# Autodesk Inventor assembly: 2ND STEP GEARX
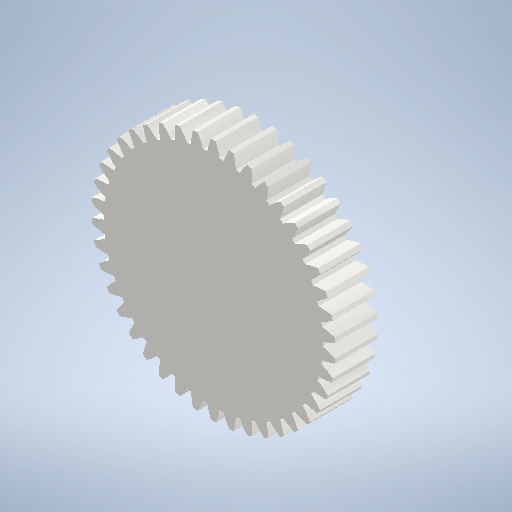
[picture p0: Inventor's stored thumbnail of the model, 512x512]
Saved by Autodesk Inventor 2026.3 (Build 303398000, 398)
## iProperties
Created: 2026-10-22
Part Number: 2ND STEP GEARX
Document SubType Name: Assembly
Designer: Salim
Author: Salim
## Documents named in this file (3)
- C:\Users\Salim\OneDrive - Universitas Negeri Malang\!! MIZURO\!!!!!!!!KSTI 2026\mizuro-ksti2026-muv\mechanical\3d design\2ND STEP GEAR.iam
- C:\Users\Salim\OneDrive - Universitas Negeri Malang\!! MIZURO\!!!!!!!!KSTI 2026\mizuro-ksti2026-muv\mechanical\3d design\3DP DIFF\Design Accelerator\Spur Gear21.ipt
- C:\Users\Salim\OneDrive - Universitas Negeri Malang\!! MIZURO\!!!!!!!!KSTI 2026\mizuro-ksti2026-muv\mechanical\3d design\3DP DIFF\Design Accelerator\Spur Gear13.ipt
## Components (2 placed, 2 different names)
1. Spur Gear2:2 — Rigid:1
2. Spur Gear1:2 — Rigid:1
## Relationships (1: WeldJoint 1)
- Rigid:1 [WeldJoint]: Spur Gear2:2 ↔ Spur Gear1:2
